# Autodesk Inventor assembly: dulap_masina_spalat
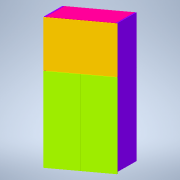
[picture p0: Inventor's stored thumbnail of the model, 180x180]
Saved by Autodesk Inventor 2022.6 (Build 266554000, 554)
## iProperties
Created: 2025-06-16
Part Number: dulap_masina_spalat
Document SubType Name: Assembly
Designer: Dragos Macovei
Author: Dragos Macovei
## Documents named in this file (8)
- C:\Users\Dragos Macovei\Documents\Inventor_3d_parts\Draghie\Masina_spalat\dulap_masina_spalat.iam
- C:\Users\Dragos Macovei\Documents\Inventor_3d_parts\Draghie\Masina_spalat\perete_lateral.ipt
- C:\Users\Dragos Macovei\Documents\Inventor_3d_parts\Draghie\Masina_spalat\polita_dulap_masina_spalat.ipt
- C:\Users\Dragos Macovei\Documents\Inventor_3d_parts\Draghie\Masina_spalat\usa_rabatabila_top.ipt
- C:\Users\Dragos Macovei\Documents\Inventor_3d_parts\Draghie\Masina_spalat\usa_jos.ipt
- C:\Users\Dragos Macovei\Documents\Inventor_3d_parts\Draghie\Masina_spalat\pfl_mic.ipt
- C:\Users\Dragos Macovei\Documents\Inventor_3d_parts\Draghie\Masina_spalat\pfl_mare.ipt
- C:\Users\Dragos Macovei\Documents\Inventor_3d_parts\Draghie\Masina_spalat\polita-pal_dublu.ipt
## Components (11 placed, 7 different names)
1. usa_jos:1 — Mate:19, Flush:30
2. usa_jos:2 — perp_p2, Mate:18, Flush:29
3. usa_rabatabila_top:1 — pe_polita, Flush:27, Flush:28, Mate:18, Mate:19
4. perete_lateral:1 — Mate:1, Flush:1, Flush:2, Mate:3, Flush:5, Flush:6, perp_p2, Flush:20, Flush:23, Mate:17, Flush:29, Mate:21
5. perete_lateral:2 — Flush:3, Mate:2, Flush:4, pe_polita, Flush:26, Flush:28, Flush:30, Flush:31
6. polita_dulap_masina_spalat:1 — Mate:1, Flush:1, Flush:2, Flush:3, Mate:2, Flush:4, Mate:13, Flush:21, Flush:27
7. polita_dulap_masina_spalat:2 — Mate:3, Flush:5, Flush:6, Flush:22, Mate:20
8. pfl_mic:1 — Mate:13, Flush:20, Flush:21
9. pfl_mare:1 — Flush:22, Flush:23
10. polita-pal_dublu:1 — Mate:17, Flush:26
11. polita-pal_dublu:2 — Mate:20, Flush:31, Mate:21
## Relationships (27: Flush 16, Mate 11)
- Mate:1: perete_lateral:1 ↔ polita_dulap_masina_spalat:1
- Flush:1: perete_lateral:1 ↔ polita_dulap_masina_spalat:1
- Flush:2: perete_lateral:1 ↔ polita_dulap_masina_spalat:1
- Flush:3: perete_lateral:2 ↔ polita_dulap_masina_spalat:1
- Mate:2: perete_lateral:2 ↔ polita_dulap_masina_spalat:1
- Flush:4: perete_lateral:2 ↔ polita_dulap_masina_spalat:1
- Mate:3: perete_lateral:1 ↔ polita_dulap_masina_spalat:2
- Flush:5: perete_lateral:1 ↔ polita_dulap_masina_spalat:2
- Flush:6: perete_lateral:1 ↔ polita_dulap_masina_spalat:2
- perp_p2 [Mate]: usa_jos:2 ↔ perete_lateral:1
- pe_polita [Mate]: usa_rabatabila_top:1 ↔ perete_lateral:2
- Mate:13: polita_dulap_masina_spalat:1 ↔ pfl_mic:1
- Flush:20: perete_lateral:1 ↔ pfl_mic:1
- Flush:21: polita_dulap_masina_spalat:1 ↔ pfl_mic:1
- Flush:22: polita_dulap_masina_spalat:2 ↔ pfl_mare:1
- Flush:23: perete_lateral:1 ↔ pfl_mare:1
- Mate:17: perete_lateral:1 ↔ polita-pal_dublu:1
- Flush:26: perete_lateral:2 ↔ polita-pal_dublu:1
- Flush:27 (-2 mm): usa_rabatabila_top:1 ↔ polita_dulap_masina_spalat:1
- Flush:28 (-2 mm): usa_rabatabila_top:1 ↔ perete_lateral:2
- Mate:18 (3 mm): usa_jos:2 ↔ usa_rabatabila_top:1
- Mate:19 (3 mm): usa_jos:1 ↔ usa_rabatabila_top:1
- Flush:29 (2 mm): usa_jos:2 ↔ perete_lateral:1
- Flush:30 (2 mm): usa_jos:1 ↔ perete_lateral:2
- Mate:20 (382 mm): polita_dulap_masina_spalat:2 ↔ polita-pal_dublu:2
- Flush:31: perete_lateral:2 ↔ polita-pal_dublu:2
- Mate:21: perete_lateral:1 ↔ polita-pal_dublu:2
